# Autodesk Inventor assembly: Assembly1
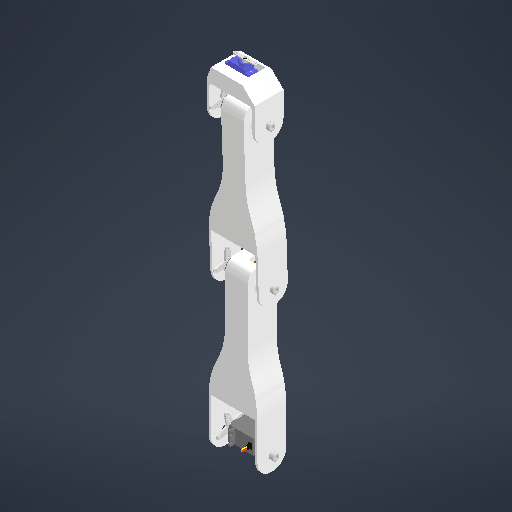
[picture p0: Inventor's stored thumbnail of the model, 512x512]
Saved by Autodesk Inventor 2027.1 (Build 311270010, 270A)
## iProperties
Created: 2025-09-24
Part Number: Assembly1
Document SubType Name: Assembly
Designer: kuusela
Author: kuusela
## Documents named in this file (10)
- C:\Users\nasra\Downloads\Arduino\KasiVarsi\.ipt .iam .step -tiedostot\Assembly1.iam
- C:\Users\nasra\Downloads\Arduino\KasiVarsi\.ipt .iam .step -tiedostot\mg996R_v2.ipt
- C:\Users\nasra\Downloads\Arduino\KasiVarsi\.ipt .iam .step -tiedostot\SG92R.ipt
- C:\Users\nasra\Downloads\Arduino\KasiVarsi\.ipt .iam .step -tiedostot\mg996_arm_4pad.ipt
- C:\Users\nasra\Downloads\Arduino\KasiVarsi\.ipt .iam .step -tiedostot\sg92r arm.ipt
- C:\Users\kuuse\Downloads\arduino uno\arduino uno.ipt
- C:\Users\nasra\Downloads\Arduino\KasiVarsi\.ipt .iam .step -tiedostot\arm1.ipt
- C:\Users\nasra\Downloads\Arduino\KasiVarsi\.ipt .iam .step -tiedostot\arm motor cover.ipt
- C:\Users\nasra\Downloads\Arduino\KasiVarsi\.ipt .iam .step -tiedostot\ranne.ipt
- C:\Users\nasra\Downloads\Arduino\KasiVarsi\.ipt .iam .step -tiedostot\Arm pin.ipt
## Components (17 placed, 9 different names)
1. mg996R_v2:1 — Mate:10, Insert:4, Insert:5, Insert:6
2. SG92R:1 — Mate:2, Mate:3, Mate:18, Mate:19, Mate:20
3. mg996_arm_4pad:1 — Insert:3, Mate:7, Mate:8, Mate:9
4. sg92r arm:1 — Mate:2, Mate:3
5. arduino uno:1
6. arm1:1 — Insert:1, Mate:4, Mate:5, Mate:6, Flush:1, Mate:11, Mate:12, Mate:21, Mate:25
7. arm1:2 — Mate:7, Mate:8, Mate:9, Mate:10, Insert:4, Insert:5, Flush:2, Mate:13, Mate:14, Mate:22, Mate:24
8. mg996R_v2:2 — Mate:4, Mate:5, Mate:6, Insert:3
9. mg996R_v2:3 — Insert:2
10. mg996_arm_4pad:2 — Insert:6, Mate:15, Mate:16, Mate:17
11. mg996_arm_4pad:3 — Insert:1, Insert:2
12. arm motor cover:1 — Flush:1, Mate:11, Mate:12
13. arm motor cover:2 — Flush:2, Mate:13, Mate:14
14. ranne:1 — Mate:15, Mate:16, Mate:17, Mate:18, Mate:19, Mate:20, Mate:23
15. Arm pin:1 — Mate:22, Flush:3, Mate:25
16. Arm pin:2 — Mate:21, Flush:3
17. Arm pin:3 — Mate:23, Mate:24
## Relationships (33: Mate 24, Insert 6, Flush 3)
- Mate:2: SG92R:1 ↔ sg92r arm:1
- Mate:3: SG92R:1 ↔ sg92r arm:1
- Insert:1: arm1:1 ↔ mg996_arm_4pad:3
- Insert:2: mg996R_v2:3 ↔ mg996_arm_4pad:3
- Mate:4: arm1:1 ↔ mg996R_v2:2
- Mate:5: arm1:1 ↔ mg996R_v2:2
- Mate:6: arm1:1 ↔ mg996R_v2:2
- Insert:3: mg996_arm_4pad:1 ↔ mg996R_v2:2
- Mate:7: mg996_arm_4pad:1 ↔ arm1:2
- Mate:8: mg996_arm_4pad:1 ↔ arm1:2
- Mate:9: mg996_arm_4pad:1 ↔ arm1:2
- Mate:10: mg996R_v2:1 ↔ arm1:2
- Insert:4: mg996R_v2:1 ↔ arm1:2
- Insert:5: mg996R_v2:1 ↔ arm1:2
- Insert:6: mg996R_v2:1 ↔ mg996_arm_4pad:2
- Flush:1: arm1:1 ↔ arm motor cover:1
- Mate:11: arm1:1 ↔ arm motor cover:1
- Mate:12: arm1:1 ↔ arm motor cover:1
- Flush:2: arm1:2 ↔ arm motor cover:2
- Mate:13: arm1:2 ↔ arm motor cover:2
- Mate:14: arm1:2 ↔ arm motor cover:2
- Mate:15: mg996_arm_4pad:2 ↔ ranne:1
- Mate:16: mg996_arm_4pad:2 ↔ ranne:1
- Mate:17: mg996_arm_4pad:2 ↔ ranne:1
- Mate:18: SG92R:1 ↔ ranne:1
- Mate:19: SG92R:1 ↔ ranne:1
- Mate:20: SG92R:1 ↔ ranne:1
- Mate:21: arm1:1 ↔ Arm pin:2
- Mate:22: arm1:2 ↔ Arm pin:1
- Flush:3: Arm pin:1 ↔ Arm pin:2
- Mate:23: ranne:1 ↔ Arm pin:3
- Mate:24: arm1:2 ↔ Arm pin:3
- Mate:25: arm1:1 ↔ Arm pin:1
